# Autodesk Inventor assembly: 外盖板
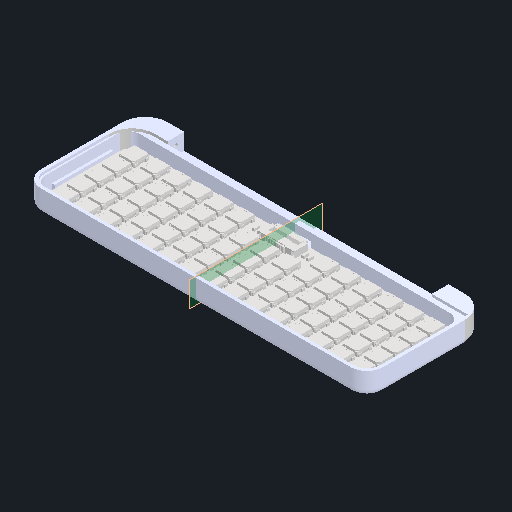
[picture p0: Inventor's stored thumbnail of the model, 512x512]
Saved by Autodesk Inventor 2025 (Build 290162000, 162)
## iProperties
Created: 2025-08-26
Part Number: 外盖板
Document SubType Name: Assembly
Designer: HZD
Author: HZD
## Documents named in this file (3)
- C:\1A_Engineering_files\Bright\散落零件\外盖板.iam
- C:\1A_Engineering_files\Bright\散落零件\零件8.ipt
- C:\1A_Engineering_files\Bright\散落零件\零件1.ipt
## Components (2 placed, 2 different names)
1. 零件8:1 — 配合:1
2. 零件1:1 — 配合:1
## Relationships (1: Mate 1)
- 配合:1 [Mate]: 零件8:1 ↔ 零件1:1
